# Autodesk Inventor assembly: Taladro de mesa
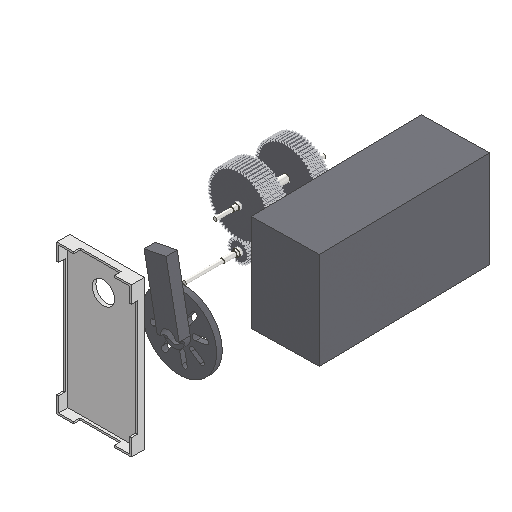
[picture p0: Inventor's stored thumbnail of the model, 512x512]
Saved by Autodesk Inventor 2027.1 (Build 311270010, 270A)
## iProperties
Created: 2026-11-15
Part Number: Taladro de mesa
Document SubType Name: Assembly
Designer: migue
Mass: 16205.5 g
Surface Area: 2546.23 cm^2
Volume: 2064.4 cm^3
Density: 7.85 g/cm^3
Author: migue
## Documents named in this file (13)
- D:\migue\OneDrive - UVG\A2UVG 2026\Diseño_2\Proyecto\Proyecto Diseño 2\Inventor\Taladro de mesa.iam
- D:\migue\OneDrive - UVG\A2UVG 2026\Diseño_2\Proyecto\Proyecto Diseño 2\Inventor\Taladro de mesa\Design Accelerator\Tren entrada.iam
- D:\migue\OneDrive - UVG\A2UVG 2026\Diseño_2\Proyecto\Proyecto Diseño 2\Inventor\Taladro de mesa\Design Accelerator\Tren salida.iam
- D:\migue\OneDrive - UVG\A2UVG 2026\Diseño_2\Proyecto\Proyecto Diseño 2\Inventor\Eje H1.ipt
- D:\migue\OneDrive - UVG\A2UVG 2026\Diseño_2\Proyecto\Proyecto Diseño 2\Inventor\Eje Entrada1.ipt
- D:\migue\OneDrive - UVG\A2UVG 2026\Diseño_2\Proyecto\Proyecto Diseño 2\Inventor\Eje medio1.ipt
- D:\migue\OneDrive - UVG\A2UVG 2026\Diseño_2\Proyecto\Proyecto Diseño 2\Inventor\Taladro de mesa\Design Accelerator\Key Connection1.iam
- D:\migue\OneDrive - UVG\A2UVG 2026\Diseño_2\Proyecto\Proyecto Diseño 2\Inventor\Taladro de mesa\Design Accelerator\Key Connection2.iam
- D:\migue\OneDrive - UVG\A2UVG 2026\Diseño_2\Proyecto\Proyecto Diseño 2\Inventor\Taladro de mesa\Design Accelerator\Key Connection3.iam
- D:\migue\OneDrive - UVG\A2UVG 2026\Diseño_2\Proyecto\Proyecto Diseño 2\Inventor\Taladro de mesa\Design Accelerator\Key Connection4.iam
- D:\migue\OneDrive - UVG\A2UVG 2026\Diseño_2\Proyecto\Proyecto Diseño 2\Inventor\Taladro de mesa\Design Accelerator\Carcaza.ipt
- D:\migue\OneDrive - UVG\A2UVG 2026\Diseño_2\Proyecto\Proyecto Diseño 2\Inventor\Taladro de mesa\Design Accelerator\base.ipt
- D:\migue\OneDrive - UVG\A2UVG 2026\Diseño_2\Proyecto\Proyecto Diseño 2\Inventor\Taladro de mesa\Design Accelerator\mesa.ipt
## Components (12 placed, 10 different names)
1. Tren entrada:1 [sub-assembly] — Mate:1, Mate:2, Mate:3, Mate:4, Angle:2, Angle:4
2. Tren salida:1 [sub-assembly] — Mate:5, Mate:6, Mate:7, Mate:8, Angle:7, Angle:9
3. Eje Entrada:1 — Mate:1, Mate:2, Mate:9, Flush:1, Angle:1, Mate:10, Angle:2
4. Eje medio:1 — Mate:3, Mate:4, Mate:7, Mate:8, Angle:4, Flush:2, Angle:5, Mate:11, Flush:3, Angle:6, Mate:12, Angle:7
5. Eje salida:1 — Mate:5, Mate:6, Mate:9, Flush:4, Angle:8, Mate:13, Angle:9
6. Cuña 1:1 [sub-assembly] — Flush:1, Angle:1, Mate:10
7. Key Connection:1 [sub-assembly] — Flush:2, Angle:5, Mate:11
8. Key Connection:2 [sub-assembly] — Flush:3, Angle:6, Mate:12
9. Key Connection:3 [sub-assembly] — Flush:4, Angle:8, Mate:13
10. Carcaza:1
11. base:1
12. mesa:1
## Relationships (25: Mate 13, Angle 8, Flush 4)
- Mate:1: Tren entrada:1 ↔ Eje Entrada:1
- Mate:2: Tren entrada:1 ↔ Eje Entrada:1
- Mate:3: Tren entrada:1 ↔ Eje medio:1
- Mate:4: Tren entrada:1 ↔ Eje medio:1
- Mate:5: Tren salida:1 ↔ Eje salida:1
- Mate:6: Tren salida:1 ↔ Eje salida:1
- Mate:7: Tren salida:1 ↔ Eje medio:1
- Mate:8: Tren salida:1 ↔ Eje medio:1
- Mate:9: Eje Entrada:1 ↔ Eje salida:1
- Flush:1 (25.4 mm): Eje Entrada:1 ↔ Cuña 1:1
- Angle:1 (0 deg): Eje Entrada:1 ↔ Cuña 1:1
- Mate:10: Eje Entrada:1 ↔ Cuña 1:1
- Angle:2 (90 deg): Tren entrada:1 ↔ Eje Entrada:1
- Angle:4 (158.3966 deg): Tren entrada:1 ↔ Eje medio:1
- Flush:2 (19.05 mm): Eje medio:1 ↔ Key Connection:1
- Angle:5 (0 deg): Eje medio:1 ↔ Key Connection:1
- Mate:11: Eje medio:1 ↔ Key Connection:1
- Flush:3 (25.4 mm): Eje medio:1 ↔ Key Connection:2
- Angle:6 (0 deg): Eje medio:1 ↔ Key Connection:2
- Mate:12: Eje medio:1 ↔ Key Connection:2
- Angle:7 (158.3966 deg): Tren salida:1 ↔ Eje medio:1
- Flush:4 (25.4 mm): Eje salida:1 ↔ Key Connection:3
- Angle:8 (0 deg): Eje salida:1 ↔ Key Connection:3
- Mate:13: Eje salida:1 ↔ Key Connection:3
- Angle:9 (90 deg): Tren salida:1 ↔ Eje salida:1
